# Autodesk Inventor assembly: Z-Axis
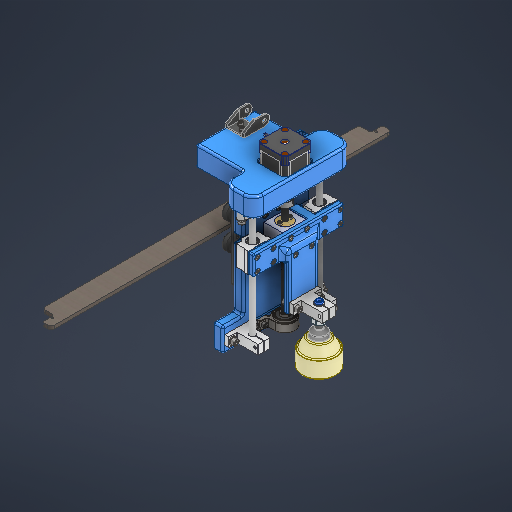
[picture p0: Inventor's stored thumbnail of the model, 512x512]
Saved by Autodesk Inventor 2027.1 (Build 311270010, 270A)
## iProperties
Created: 2026-10-04
Part Number: Z-Axis
Document SubType Name: Assembly
Designer: Ahmed
Author: Ahmed
## iProperties of the stored document nippel.ipt
Created: 2014-03-17
Part Number: nippel
Material: Generic
Document SubType Name: Modeling
Designer: Ahmed
Density: 1 g/cm^3
Appearance: Default
Mass: 1.51643 g
Surface Area: 12.4065 cm^2
Volume: 1.51643 cm^3
Sending System: SOLIDWORKS 2012
Last Saved Date: 2014-05-13
last saved by: Oleg
Author: Ahmed
## iProperties of the stored document Gantry_Plate_65x65.ipt
Created: 2024-03-15
Part Number: Gantry_Plate_65x65
Material: Generic
Description: STEP AP214
Document SubType Name: Modeling
Designer: Ahmed
Density: 1 g/cm^3
Appearance: Default
Mass: 10.5497 g
Surface Area: 93.2193 cm^2
Volume: 10.5497 cm^3
Sending System: SolidWorks 2024
Preprocessor: SwSTEP 2.0
Title: Gantry_Plate_65x65.STEP
Revision Number: ANY
## iProperties of the stored document IPCF06-02.iam
Company: Open CASCADE
Created: 2026-10-23
Part Number: IPCF06-02
Description: Open CASCADE Model
Document SubType Name: Assembly
Designer: Ahmed
Authority: Unknown
Mass: 1.21454 g
Surface Area: 16.1477 cm^2
Volume: 1.21454 cm^3
Density: 1 g/cm^3
Sending System: Open CASCADE 7.9
Preprocessor: Open CASCADE STEP processor 7.9
Title: Open CASCADE Shape Model
Author: Author
## iProperties of the stored document Insert M3 D5 L5mm.ipt
Created: 2022-05-23
Part Number: Document
Material: Generic
Document SubType Name: Modeling
Designer: Ahmed
Density: 1 g/cm^3
Appearance: Default
Mass: 0.0567155 g
Surface Area: 2.1125 cm^2
Volume: 0.0567155 cm^3
Preprocessor: ST-DEVELOPER v16.5
Title: Insert M3 D5 L5mm
Revision Number: AFirst version
## iProperties of the stored document Suction-ohne-nippel.ipt
Created: 2014-03-17
Part Number: Suction-ohne-nippel
Material: Generic
Document SubType Name: Modeling
Designer: Ahmed
Density: 1 g/cm^3
Appearance: Default
Mass: 1.14453 g
Surface Area: 25.0648 cm^2
Volume: 1.14453 cm^3
Sending System: SOLIDWORKS 2012
Last Saved Date: 2014-05-13
last saved by: Oleg
Author: Ahmed
## iProperties of the stored document release_ring.ipt
Created: 2026-10-23
Part Number: release_ring
Material: Generic
Document SubType Name: Modeling
Designer: Ahmed
Density: 1 g/cm^3
Appearance: Default
Mass: 0.104785 g
Surface Area: 2.06972 cm^2
Volume: 0.104785 cm^3
Author: Ahmed
## iProperties of the stored document Suction.iam
Created: 2014-03-17
Part Number: Suction
Document SubType Name: Assembly
Designer: Ahmed
Mass: 2.66095 g
Surface Area: 37.4713 cm^2
Volume: 2.66095 cm^3
Density: 1 g/cm^3
Sending System: SOLIDWORKS 2012
last saved by: Oleg
Last Saved Date: 2014-05-13
Author: Ahmed
## iProperties of the stored document body.ipt
Created: 2026-10-23
Part Number: body
Material: Generic
Document SubType Name: Modeling
Designer: Ahmed
Density: 1 g/cm^3
Appearance: Default
Mass: 1.10976 g
Surface Area: 14.0779 cm^2
Volume: 1.10976 cm^3
Author: Ahmed
## Documents named in this file (57)
- C:\Users\Ahmed\Desktop\Fall 26\MCT333 Design of Mechatronics Systems 1\Project\CAD\Z-Axis.iam
- C:\Users\Ahmed\Desktop\Fall 26\MCT333 Design of Mechatronics Systems 1\Project\CAD\AluminumExtrusion\AluminumExtrusion\AluminiumExtrusion2020\2020extrusion_ipt\2020aluminum_extrusion_black.ipt
- C:\Users\Ahmed\Desktop\Fall 26\MCT333 Design of Mechatronics Systems 1\Project\CAD\V-Pulley.ipt
- C:\Users\Ahmed\Desktop\Fall 26\MCT333 Design of Mechatronics Systems 1\Project\CAD\VSoltGantrySetAllSizes\VSoltGantrySetAllSizes\40mm Gantry Set universal\127x88 Gantry.ipt
- C:\Users\Ahmed\Desktop\Fall 26\MCT333 Design of Mechatronics Systems 1\Project\CAD\sk8-linear-shaft-support-8mm-1.snapshot.1\SK8 Linear Shaft Support, 8mm v4\SK8 Linear Shaft Support, 8mm v4.ipt
- C:\Users\Ahmed\Desktop\Fall 26\MCT333 Design of Mechatronics Systems 1\Project\CAD\scs8uu-linear-bearing-block-8mm-shaft-1.snapshot.1\SCS8UU Block, Linear Bearing, 8mm Shaft v4\SCS8UU Block, Linear Bearing, 8mm.ipt
- C:\Users\Ahmed\Desktop\Fall 26\MCT333 Design of Mechatronics Systems 1\Project\CAD\shf10-shf8-linear-shaft-support-1.snapshot.6\SHF8\SHF8.ipt
- C:\Users\Ahmed\Desktop\Fall 26\MCT333 Design of Mechatronics Systems 1\Project\CAD\KP08 Pillow block bearing 08mm diameter\KP08 Pillow block bearing 08mm diameter.ipt
- C:\Users\Ahmed\Desktop\Fall 26\MCT333 Design of Mechatronics Systems 1\Project\CAD\nema-17-40mm-stepper-motor-1.snapshot.22\17HM15-0904S\17HM15-0904S\17HM15-0904S.ipt
- C:\Users\Ahmed\Desktop\Fall 26\MCT333 Design of Mechatronics Systems 1\Project\CAD\aluminum-flexible-shaft-coupling-5mm-x-8mm-1.snapshot.1\Flexible Shaft Coupling 5mm to 8mm\Flexible_Shaft_Coupling_5_to_8mm v7.ipt
- C:\Users\Ahmed\Desktop\Fall 26\MCT333 Design of Mechatronics Systems 1\Project\CAD\Z Bracket.ipt
- C:\Users\Ahmed\Desktop\Fall 26\MCT333 Design of Mechatronics Systems 1\Project\CAD\tr8x8-4-8mm-4-start-lead-screw-1.snapshot.6\Trapezoidal lead screw tr8x8-4\Trapezoidal lead screw tr8x8-4.ipt
- C:\Users\Ahmed\Desktop\Fall 26\MCT333 Design of Mechatronics Systems 1\Project\CAD\t8_nut_housing\t8_nut_housing.ipt
- C:\Users\Ahmed\Desktop\Fall 26\MCT333 Design of Mechatronics Systems 1\Project\CAD\shf10-shf8-linear-shaft-support-1.snapshot.6\SHF8\SHF8_MIR.ipt
- C:\Users\Ahmed\Desktop\Fall 26\MCT333 Design of Mechatronics Systems 1\Project\CAD\Linear Guide Rods.ipt
- C:\Users\Ahmed\Documents\Inventor\Content Center Files\R2027\en-US\ISO 4032(2)\ISO 4032 - M5 - ISO.ipt
- C:\Users\Ahmed\Documents\Inventor\Content Center Files\R2027\en-US\ISO 4762(2)\ISO 4762 - M5 x 16ISO.ipt
- C:\Users\Ahmed\Desktop\Fall 26\MCT333 Design of Mechatronics Systems 1\Project\CAD\Bearing Spacer.ipt
- C:\Users\Ahmed\Desktop\Fall 26\MCT333 Design of Mechatronics Systems 1\Project\CAD\Insert M5 D7 L9.5mm\Insert M5 D7 L9.5mm.ipt
- C:\Users\Ahmed\Desktop\Fall 26\MCT333 Design of Mechatronics Systems 1\Project\CAD\M4 Insert\M4 Insert.ipt
- C:\Users\Ahmed\Documents\Inventor\Content Center Files\R2027\en-US\ISO 4762(2)\ISO 4762 - M5 x 20ISO.ipt
- C:\Users\Ahmed\Documents\Inventor\Content Center Files\R2027\en-US\ISO 4762(2)\ISO 4762 - M4 x 16ISO.ipt
- C:\Users\Ahmed\Documents\Inventor\Content Center Files\R2027\en-US\ISO 4762(2)\ISO 4762 - M3 x 16ISO.ipt
- C:\Users\Ahmed\Desktop\Fall 26\MCT333 Design of Mechatronics Systems 1\Project\CAD\Linear Bearing Spacer.ipt
- C:\Users\Ahmed\Desktop\Fall 26\MCT333 Design of Mechatronics Systems 1\Project\CAD\T8 nut\T8 nut.ipt
- C:\Users\Ahmed\Documents\Inventor\Content Center Files\R2027\en-US\ISO 4762(2)\ISO 4762 - M3 x 12ISO.ipt
- C:\Users\Ahmed\Desktop\Fall 26\MCT333 Design of Mechatronics Systems 1\Project\CAD\NO-NC Bump Switch\NO-NC Bump Switch.ipt
- C:\Users\Ahmed\Desktop\Fall 26\MCT333 Design of Mechatronics Systems 1\Project\CAD\Limit Switch Spacer.ipt
- C:\Users\Ahmed\Desktop\Fall 26\MCT333 Design of Mechatronics Systems 1\Project\CAD\SK12 SHAFT HOLDER\SK12 SHAFT HOLDER.ipt
- C:\Users\Ahmed\Desktop\Fall 26\MCT333 Design of Mechatronics Systems 1\Project\CAD\Suction Cup Fixation.ipt
- **C:\Users\Ahmed\Desktop\Fall 26\MCT333 Design of Mechatronics Systems 1\Project\CAD\Z-Axis.iam*LocalDocs*xAaaaqrcaAaaaaaaaAaaaavx32f*Suction.iam
- C:\Users\Ahmed\Documents\Inventor\Content Center Files\R2027\en-US\ISO 4762(2)\ISO 4762 - M4 x 12ISO.ipt
- C:\Users\Ahmed\Documents\Inventor\Content Center Files\R2027\en-US\ISO 4762(2)\ISO 4762 - M4 x 8ISO.ipt
- C:\Users\Ahmed\Desktop\Fall 26\MCT333 Design of Mechatronics Systems 1\Project\CAD\Product Base.ipt
- **C:\Users\Ahmed\Desktop\Fall 26\MCT333 Design of Mechatronics Systems 1\Project\CAD\Z-Axis.iam*LocalDocs*xAaaaa4daAaaaaaaaAaaaqi4fEb*IPCF06-02.iam
- C:\Users\Ahmed\Documents\Inventor\Content Center Files\R2027\en-US\ANSI B18.22 M\ANSI B18.22M - 5 N.ipt
- C:\Users\Ahmed\Documents\Inventor\Content Center Files\R2027\en-US\ISO 4032(2)\ISO 4032 - M2 - ISO.ipt
- C:\Users\Ahmed\Documents\Inventor\Content Center Files\R2027\en-US\ANSI B18.22 M\ANSI B18.22M - 2 N.ipt
- C:\Users\Ahmed\Documents\Inventor\Content Center Files\R2027\en-US\ISO 4762(2)\ISO 4762 - M2 x 16ISO.ipt
- **C:\Users\Ahmed\Desktop\Fall 26\MCT333 Design of Mechatronics Systems 1\Project\CAD\Z-Axis.iam*LocalDocs*xAaaaq5baAaaaaaaaAaaaqochXh*Insert M3 D5 L5mm.ipt
- C:\Users\Ahmed\Documents\Inventor\Content Center Files\R2027\en-US\ANSI B18.22 M\ANSI B18.22M - 3 N.ipt
- **C:\Users\Ahmed\Desktop\Fall 26\MCT333 Design of Mechatronics Systems 1\Project\CAD\Z-Axis.iam*LocalDocs*xAaaaq4baAaaaaaaaAaaaa31b2g*Gantry_Plate_65x65.ipt
- C:\Users\Ahmed\Desktop\Fall 26\MCT333 Design of Mechatronics Systems 1\Project\CAD\Drag Chain Support.ipt
- C:\Users\Ahmed\Desktop\Fall 26\MCT333 Design of Mechatronics Systems 1\Project\CAD\Drag Chain Start Link.ipt
- C:\Users\Ahmed\Desktop\Fall 26\MCT333 Design of Mechatronics Systems 1\Project\CAD\Drag Chain Middle Link.ipt
- C:\Users\Ahmed\Desktop\Fall 26\MCT333 Design of Mechatronics Systems 1\Project\CAD\Path.ipt
- C:\Users\Ahmed\Desktop\Fall 26\MCT333 Design of Mechatronics Systems 1\Project\CAD\GT2 Belt 6mm x 40mm\GT2 Belt 6mm x 40mm.ipt
- C:\Users\Ahmed\Desktop\Fall 26\MCT333 Design of Mechatronics Systems 1\Project\CAD\Insert M3 D5 L5mm.stp
- **C:\Users\Ahmed\Desktop\Fall 26\MCT333 Design of Mechatronics Systems 1\Project\CAD\Z-Axis.iam*LocalDocs*xAaaaqcaaAaaaaaaaAaaaartaHg*nippel.ipt
- **C:\Users\Ahmed\Desktop\Fall 26\MCT333 Design of Mechatronics Systems 1\Project\CAD\Z-Axis.iam*LocalDocs*xAaaaqzaaAaaaaaaaAaaaqmsjBh*body.ipt
- **C:\Users\Ahmed\Desktop\Fall 26\MCT333 Design of Mechatronics Systems 1\Project\CAD\Z-Axis.iam*LocalDocs*xAaaaqibaAaaaaaaaAaaaq5znNd*release_ring.ipt
- **C:\Users\Ahmed\Desktop\Fall 26\MCT333 Design of Mechatronics Systems 1\Project\CAD\Z-Axis.iam*LocalDocs*xAaaaqocaAaaaaaaaAaaaahhiSh*Suction-ohne-nippel.ipt
- C:\Users\Ahmed\Desktop\Fall 26\MCT333 Design of Mechatronics Systems 1\Project\CAD\Suction.SLDASM
- C:\Users\Ahmed\Desktop\Fall 26\MCT333 Design of Mechatronics Systems 1\Project\CAD\nippel.SLDPRT
- C:\Users\Ahmed\Desktop\Fall 26\MCT333 Design of Mechatronics Systems 1\Project\CAD\Suction-ohne-nippel.SLDPRT
- C:\Users\Ahmed\Desktop\Fall 26\MCT333 Design of Mechatronics Systems 1\Project\CAD\IPCF06-02.step
- C:\Users\Ahmed\Desktop\Fall 26\MCT333 Design of Mechatronics Systems 1\Project\CAD\Gantry_Plate_65x65.STEP
## Components (168 placed, 46 different names)
1. 2020aluminum_extrusion_black:1 — Tangent:9, Tangent:10, Tangent:11, Tangent:12, Mate:245, Mate:246, Mate:247, Mate:248, Mate:249, Mate:250, Mate:252, Mate:264, Mate:266, Flush:22, Flush:23
2. SCS8UU Block, Linear Bearing, 8mm:1 — Mate:34, Angle:5, Flush:5, Mate:78
3. 17HS4401:1 — Mate:7, Mate:8, Mate:224, Mate:225
4. Flexible_Shaft_Coupling_5_to_8mm v7:1 — Mate:8, Mate:10, Mate:12, Mate:33, Mate:63
5. Z Bracket:1 — Mate:2, Mate:3, Mate:4, Mate:7, Mate:10, Angle:1, Mate:18, Mate:19, Mate:20, Mate:21, Mate:22, Mate:26, Mate:27, Mate:28, Mate:30, Mate:32, Angle:6, Mate:38, Angle:7, Mate:41, Mate:42, Mate:43, Mate:44, Mate:45, Mate:47, Mate:48, Mate:49, Mate:50, Mate:51, Mate:52, Mate:53, Flush:7, Mate:54, Flush:8, Mate:55, Flush:9, Mate:56, Flush:10, Mate:57, Mate:58, Mate:59, Mate:60, Flush:11, Flush:12, Flush:13, Flush:14, Mate:61, Mate:62, Flush:15, Flush:16, Insert:15, Insert:16, Insert:17, Insert:18, Insert:23, Insert:24, Insert:25, Insert:26, Insert:29, Insert:30, Insert:31, Insert:32, Insert:35, Insert:36, Mate:206, Mate:209, Mate:210, Angle:8, Mate:217, Insert:37, Insert:38, Mate:235, Flush:17, Mate:236, Flush:18, Mate:257, Flush:25
6. Trapezoidal lead screw tr8x8-4:1 — Mate:12, Mate:13, Mate:33
7. t8_nut_housing:1 — Mate:13, Angle:1, Angle:4, Angle:5, Flush:5, Flush:6, Mate:63, Mate:81, Mate:82, Mate:83, Mate:107, Mate:109
8. SCS8UU Block, Linear Bearing, 8mm:2 — Mate:35, Angle:4, Flush:6, Mate:75, Mate:76
9. M4 Insert:1 — Mate:61, Flush:16
10. M4 Insert:2 — Mate:62, Flush:15
11. ISO 4762 M3 x 16:1 — Insert:23
12. ISO 4762 M3 x 16:2 — Insert:24, Mate:225
13. ISO 4762 M3 x 16:3 — Insert:25, Mate:224
14. ISO 4762 M3 x 16:4 — Insert:26
15. Linear Bearing Spacer:1 — Mate:78, Mate:148, Mate:149
16. Linear Bearing Spacer:2 — Mate:75, Mate:76, Mate:108, Mate:179
17. T8 nut:1 — Mate:81, Mate:82, Mate:83, Mate:84, Mate:85, Mate:86, Mate:87
18. ISO 4762 M3 x 12:1 — Mate:84, Mate:87
19. ISO 4762 M3 x 12:2 — Mate:85, Mate:86
20. SK12 SHAFT HOLDER:1 — Mate:110, Mate:111, Mate:112, Mate:113, Mate:114, Mate:134, Mate:135, Mate:136, Mate:137, Mate:146, Insert:47
21. Suction Cup Fixation:1 — Mate:107, Mate:108, Mate:109, Mate:110, Mate:111, Mate:112, Mate:118, Mate:119, Mate:120, Mate:121, Mate:122, Mate:123, Mate:124, Mate:125, Mate:126, Mate:127, Mate:128, Mate:129, Mate:130, Mate:131, Mate:132, Mate:133, Mate:150, Mate:151, Mate:152, Mate:153, Mate:154, Mate:155, Mate:156, Mate:157, Insert:33, Insert:34
22. Suction:1 [sub-assembly] — Mate:113, Mate:114, Mate:144, Mate:145, Mate:147
23. ISO 4762 M4 x 12:2 — Mate:118, Mate:120
24. ISO 4762 M4 x 12:1 — Mate:119, Mate:121
25. ISO 4762 M4 x 12:3 — Mate:123, Mate:124, Mate:149
26. ISO 4762 M4 x 12:4 — Mate:122, Mate:125, Mate:148
27. ISO 4762 M4 x 12:5 — Mate:151, Mate:155, Mate:179
28. ISO 4762 M4 x 8:1 — Mate:126, Mate:127
29. ISO 4762 M4 x 8:2 — Mate:128, Mate:129
30. ISO 4762 M4 x 16:3 — Mate:130, Mate:133
31. ISO 4762 M4 x 16:4 — Mate:131, Mate:132
32. ISO 4762 M5 x 20:14 — Mate:134, Mate:135, Mate:158
33. ISO 4762 M5 x 20:13 — Mate:136, Mate:137, Mate:160
34. Product Base:1 — Mate:144, Mate:145
35. IPCF06-02:1 [sub-assembly] — Mate:146, Mate:147
36. ISO 4762 M4 x 12:6 — Mate:150, Mate:154
37. ISO 4762 M4 x 12:7 — Mate:152, Mate:157
38. ISO 4762 M4 x 12:8 — Mate:153, Mate:156
39. ISO 4032 M5:13 — Mate:158, Mate:161
40. ISO 4032 M5:14 — Mate:160, Mate:162
41. Plain Washer (Metric) 5 N:1 — Insert:33, Mate:161
42. Plain Washer (Metric) 5 N:2 — Insert:34, Mate:162
43. Limit Switch Spacer:1 — Mate:206, Mate:207, Mate:208, Mate:211
44. Insert M3 D5 L5mm:1 — Mate:235, Flush:17, Mate:238
45. Insert M3 D5 L5mm:2 — Mate:236, Flush:18, Mate:237, Mate:268
46. ISO 4762 M3 x 12:3 — Mate:238, Mate:242, Mate:244
47. ISO 4762 M3 x 12:4 — Mate:237, Mate:239, Mate:240
48. Plain Washer (Metric) 3 N:2 — Mate:242, Mate:244, Mate:270
49. Plain Washer (Metric) 3 N:1 — Mate:239, Mate:240, Mate:269
50. Gantry_Plate_65x65:1 — Mate:248, Mate:249, Mate:250, Mate:251, Mate:253
51. Gantry_Plate_65x65:2 — Mate:245, Mate:246, Mate:247, Mate:263, Mate:272
52. Drag Chain Support:1 — Mate:251, Mate:252, Mate:253, Mate:254, Angle:9, Mate:267, Angle:10
53. Drag Chain Start Link:1 — Mate:257, Mate:264, Mate:268, Mate:269, Mate:270, Mate:272, Flush:19
54. Drag Chain Start Link:2 — Mate:254, Angle:9, Mate:266, Mate:267, Mate:273, Flush:20
55. Path:1 — Flush:19
56. GT2 Belt 6mm x 40mm:1 — Flush:21, Flush:22
57. GT2 Belt 6mm x 40mm:2 — Flush:23, Flush:24
58. ISO 4762 M4 x 16:5 — Insert:47
59. Plain Washer (Metric) 2 N:5 — Mate:233
60. Plain Washer (Metric) 2 N:4 — Mate:234
61. Limit Switch Spacer:2 — Mate:213, Mate:214, Mate:216, Angle:8, Mate:217
62. NO-NC Bump Switch:2 — Mate:213, Mate:214, Mate:216, Mate:219, Mate:231, Mate:232, Mate:233, Mate:234, Flush:25
63. ISO 4032 M2:3 — Insert:37
64. ISO 4032 M2:4 — Insert:38
65. ISO 4762 M2 x 16:3 — Mate:231
66. ISO 4762 M2 x 16:4 — Mate:232
67. NO-NC Bump Switch:3 — Mate:197, Mate:198, Mate:201, Mate:203, Mate:211
68. ISO 4032 M2:2 — Insert:36
69. ISO 4032 M2:1 — Insert:35
70. ISO 4762 M2 x 16:2 — Mate:197, Mate:200, Mate:205, Mate:208, Mate:210
71. ISO 4762 M2 x 16:1 — Mate:198, Mate:202, Mate:204, Mate:207, Mate:209
72. Plain Washer (Metric) 2 N:2 — Mate:200, Mate:201, Mate:205
73. Plain Washer (Metric) 2 N:3 — Mate:202, Mate:203, Mate:204
74. 127x88 Gantry:1 — Insert:2, Insert:4, Mate:2, Mate:3, Mate:4, Insert:27, Insert:28, Mate:164, Mate:168, Mate:169, Mate:170, Mate:175, Mate:176, Mate:177, Mate:178, Mate:263, Flush:21, Flush:24
75. V-Pulley:1 — Insert:2
76. V-Pulley:2 — Insert:4
77. V-Pulley:3 — Insert:28, Tangent:11, Tangent:12
78. V-Pulley:4 — Insert:27, Tangent:9, Tangent:10
79. ISO 4762 M5 x 20:11 — Insert:30, Mate:103, Mate:163
80. ISO 4032 M5:10 — Mate:100, Mate:103
81. Plain Washer (Metric) 5 N:3 — Mate:163, Mate:164, Mate:100
82. ISO 4762 M5 x 20:5 — Insert:15, Mate:88, Mate:167
83. ISO 4032 M5:6 — Mate:88, Mate:89
84. Plain Washer (Metric) 5 N:5 — Mate:167, Mate:168, Mate:89
85. ISO 4762 M5 x 20:6 — Insert:16, Mate:90, Mate:166
86. ISO 4032 M5:7 — Mate:90, Mate:95
87. Plain Washer (Metric) 5 N:4 — Mate:166, Mate:169, Mate:95
88. ISO 4762 M5 x 20:10 — Insert:31, Mate:102, Mate:165
89. ISO 4032 M5:12 — Mate:98, Mate:102
90. Plain Washer (Metric) 5 N:6 — Mate:165, Mate:170, Mate:98
91. ISO 4762 M5 x 20:7 — Insert:17, Mate:92, Mate:172
92. ISO 4032 M5:9 — Mate:92, Mate:93
93. Plain Washer (Metric) 5 N:8 — Mate:172, Mate:177, Mate:93
94. ISO 4762 M5 x 20:8 — Insert:18, Mate:91, Mate:173
95. ISO 4032 M5:8 — Mate:91, Mate:94
96. Plain Washer (Metric) 5 N:10 — Mate:173, Mate:176, Mate:94
97. ISO 4762 M5 x 20:12 — Insert:32, Mate:101, Mate:171
98. ISO 4032 M5:11 — Mate:99, Mate:101
99. Plain Washer (Metric) 5 N:9 — Mate:171, Mate:178, Mate:99
100. ISO 4762 M5 x 20:9 — Insert:29, Mate:96, Mate:174
101. ISO 4032 M5:5 — Mate:96, Mate:97
102. Plain Washer (Metric) 5 N:7 — Mate:174, Mate:175, Mate:97
103. KP08 Pillow block bearing 08mm diameter:1 — Mate:47, Mate:48, Mate:49, Insert:13, Insert:14
104. ISO 4762 M4 x 16:1 — Insert:13
105. Bearing Spacer:1 — Mate:50, Mate:51, Mate:52, Mate:219
106. ISO 4762 M4 x 16:2 — Insert:14
107. Linear Guide Rods:2 — Mate:29, Mate:30, Mate:35
108. Linear Guide Rods:1 — Mate:32, Mate:34, Mate:36, Mate:46
109. SHF8:1 — Mate:19, Mate:20, Mate:21, Mate:22, Insert:5, Insert:6, Insert:43, Insert:44
110. SHF8_MIR:1 — Mate:26, Mate:27, Mate:28, Insert:7, Insert:8, Insert:45, Insert:46
111. SK8 Linear Shaft Support, 8mm v4:1 — Mate:18, Mate:29, Mate:41, Mate:42, Insert:9, Insert:10, Insert:39, Insert:40
112. SK8 Linear Shaft Support, 8mm v4:2 — Mate:43, Mate:44, Mate:45, Mate:46, Insert:11, Insert:12, Insert:41, Insert:42
113. Insert M5 D7 L9.5mm:1 — Mate:53, Flush:7
114. Insert M5 D7 L9.5mm:2 — Mate:54, Flush:8
115. Insert M5 D7 L9.5mm:3 — Mate:55, Flush:9
116. Insert M5 D7 L9.5mm:4 — Mate:56, Flush:10
117. Insert M5 D7 L9.5mm:5 — Mate:58, Flush:13
118. Insert M5 D7 L9.5mm:6 — Mate:57, Flush:14
119. Insert M5 D7 L9.5mm:7 — Mate:59, Flush:11
120. Insert M5 D7 L9.5mm:8 — Mate:60, Flush:12
121. ISO 4762 M5 x 20:1 — Insert:5
122. Plain Washer (Metric) 5 N:15 — Insert:43
123. ISO 4762 M5 x 20:2 — Insert:6
124. Plain Washer (Metric) 5 N:16 — Insert:44
125. ISO 4762 M5 x 20:3 — Insert:7
126. Plain Washer (Metric) 5 N:18 — Insert:45
127. ISO 4762 M5 x 20:4 — Insert:8
128. Plain Washer (Metric) 5 N:17 — Insert:46
129. ISO 4762 M5 x 16:4 — Insert:11
130. Plain Washer (Metric) 5 N:13 — Insert:41
131. ISO 4762 M5 x 16:3 — Insert:12
132. Plain Washer (Metric) 5 N:14 — Insert:42
133. Plain Washer (Metric) 5 N:12 — Insert:40
134. ISO 4762 M5 x 16:2 — Insert:10
135. Plain Washer (Metric) 5 N:11 — Insert:39
136. ISO 4762 M5 x 16:1 — Insert:9
137. Drag Chain Middle Link:1 — Mate:273, Angle:10, Flush:20
138. Drag Chain Middle Link:2
139. Drag Chain Middle Link:3
140. Drag Chain Middle Link:4
141. Drag Chain Middle Link:5
142. Drag Chain Middle Link:6
143. Drag Chain Middle Link:7
144. Drag Chain Middle Link:8
145. Drag Chain Middle Link:9
146. Drag Chain Middle Link:10
147. Drag Chain Middle Link:11
148. Drag Chain Middle Link:12
149. Drag Chain Middle Link:13
150. Drag Chain Middle Link:14
151. Drag Chain Middle Link:15
152. Drag Chain Middle Link:16
153. Drag Chain Middle Link:17
154. Drag Chain Middle Link:18
155. Drag Chain Middle Link:19
156. Drag Chain Middle Link:20
157. Drag Chain Middle Link:21
158. Drag Chain Middle Link:22
159. Drag Chain Middle Link:23
160. Drag Chain Middle Link:24
161. Drag Chain Middle Link:25
162. Drag Chain Middle Link:26
163. Drag Chain Middle Link:27
164. Drag Chain Middle Link:28
165. Drag Chain Middle Link:29
166. Drag Chain Middle Link:30
167. Drag Chain Middle Link:31
168. Drag Chain Middle Link:32
## Component patterns: (32 elements, first: Drag Chain Middle Link:1)
## Relationships (269: Mate 195, Insert 41, Flush 21, Angle 8, Tangent 4)
- Insert:2: 127x88 Gantry:1 ↔ V-Pulley:1
- Insert:4: 127x88 Gantry:1 ↔ V-Pulley:2
- Mate:2: Z Bracket:1 ↔ 127x88 Gantry:1
- Mate:3: Z Bracket:1 ↔ 127x88 Gantry:1
- Mate:4: Z Bracket:1 ↔ 127x88 Gantry:1
- Mate:7: 17HS4401:1 ↔ Z Bracket:1
- Mate:8: 17HS4401:1 ↔ Flexible_Shaft_Coupling_5_to_8mm v7:1
- Mate:10: Flexible_Shaft_Coupling_5_to_8mm v7:1 ↔ Z Bracket:1
- Mate:12: Flexible_Shaft_Coupling_5_to_8mm v7:1 ↔ Trapezoidal lead screw tr8x8-4:1
- Mate:13: Trapezoidal lead screw tr8x8-4:1 ↔ t8_nut_housing:1
- Angle:1 (0 deg): Z Bracket:1 ↔ t8_nut_housing:1
- Mate:18: Z Bracket:1 ↔ SK8 Linear Shaft Support, 8mm v4:1
- Mate:19: Z Bracket:1 ↔ SHF8:1
- Mate:20: Z Bracket:1 ↔ SHF8:1
- Mate:21: Z Bracket:1 ↔ SHF8:1
- Mate:22: Z Bracket:1 ↔ SHF8:1
- Mate:26: Z Bracket:1 ↔ SHF8_MIR:1
- Mate:27: Z Bracket:1 ↔ SHF8_MIR:1
- Mate:28: Z Bracket:1 ↔ SHF8_MIR:1
- Mate:29: Linear Guide Rods:2 ↔ SK8 Linear Shaft Support, 8mm v4:1
- Mate:30: Z Bracket:1 ↔ Linear Guide Rods:2
- Mate:32: Z Bracket:1 ↔ Linear Guide Rods:1
- Mate:33: Flexible_Shaft_Coupling_5_to_8mm v7:1 ↔ Trapezoidal lead screw tr8x8-4:1
- Mate:34: SCS8UU Block, Linear Bearing, 8mm:1 ↔ Linear Guide Rods:1
- Mate:35: SCS8UU Block, Linear Bearing, 8mm:2 ↔ Linear Guide Rods:2
- Angle:4 (0 deg): t8_nut_housing:1 ↔ SCS8UU Block, Linear Bearing, 8mm:2
- Angle:5 (0 deg): SCS8UU Block, Linear Bearing, 8mm:1 ↔ t8_nut_housing:1
- Mate:36: Linear Guide Rods:1
- Mate:37
- Angle:6 (90 deg): Z Bracket:1
- Mate:38: Z Bracket:1
- Mate:39
- Angle:7 (90 deg): Z Bracket:1
- Flush:5: SCS8UU Block, Linear Bearing, 8mm:1 ↔ t8_nut_housing:1
- Flush:6: t8_nut_housing:1 ↔ SCS8UU Block, Linear Bearing, 8mm:2
- Mate:41: Z Bracket:1 ↔ SK8 Linear Shaft Support, 8mm v4:1
- Mate:42: Z Bracket:1 ↔ SK8 Linear Shaft Support, 8mm v4:1
- Mate:43: Z Bracket:1 ↔ SK8 Linear Shaft Support, 8mm v4:2
- Mate:44: Z Bracket:1 ↔ SK8 Linear Shaft Support, 8mm v4:2
- Mate:45: Z Bracket:1 ↔ SK8 Linear Shaft Support, 8mm v4:2
- Mate:46: Linear Guide Rods:1 ↔ SK8 Linear Shaft Support, 8mm v4:2
- Mate:47: Z Bracket:1 ↔ KP08 Pillow block bearing 08mm diameter:1
- Mate:48: Z Bracket:1 ↔ KP08 Pillow block bearing 08mm diameter:1
- Mate:49: Z Bracket:1 ↔ KP08 Pillow block bearing 08mm diameter:1
- Mate:50: Z Bracket:1 ↔ Bearing Spacer:1
- Mate:51: Z Bracket:1 ↔ Bearing Spacer:1
- Mate:52: Z Bracket:1 ↔ Bearing Spacer:1
- Mate:53: Z Bracket:1 ↔ Insert M5 D7 L9.5mm:1
- Flush:7: Z Bracket:1 ↔ Insert M5 D7 L9.5mm:1
- Mate:54: Z Bracket:1 ↔ Insert M5 D7 L9.5mm:2
- Flush:8: Z Bracket:1 ↔ Insert M5 D7 L9.5mm:2
- Mate:55: Z Bracket:1 ↔ Insert M5 D7 L9.5mm:3
- Flush:9: Z Bracket:1 ↔ Insert M5 D7 L9.5mm:3
- Mate:56: Z Bracket:1 ↔ Insert M5 D7 L9.5mm:4
- Flush:10: Z Bracket:1 ↔ Insert M5 D7 L9.5mm:4
- Mate:57: Z Bracket:1 ↔ Insert M5 D7 L9.5mm:6
- Mate:58: Z Bracket:1 ↔ Insert M5 D7 L9.5mm:5
- Mate:59: Z Bracket:1 ↔ Insert M5 D7 L9.5mm:7
- Mate:60: Z Bracket:1 ↔ Insert M5 D7 L9.5mm:8
- Flush:11: Z Bracket:1 ↔ Insert M5 D7 L9.5mm:7
- Flush:12: Z Bracket:1 ↔ Insert M5 D7 L9.5mm:8
- Flush:13: Z Bracket:1 ↔ Insert M5 D7 L9.5mm:5
- Flush:14: Z Bracket:1 ↔ Insert M5 D7 L9.5mm:6
- Mate:61: Z Bracket:1 ↔ M4 Insert:1
- Mate:62: Z Bracket:1 ↔ M4 Insert:2
- Flush:15: Z Bracket:1 ↔ M4 Insert:2
- Flush:16: Z Bracket:1 ↔ M4 Insert:1
- Insert:5 (1.4 mm): SHF8:1 ↔ ISO 4762 M5 x 20:1
- Insert:6 (1.4 mm): SHF8:1 ↔ ISO 4762 M5 x 20:2
- Insert:7 (1.4 mm): SHF8_MIR:1 ↔ ISO 4762 M5 x 20:3
- Insert:8 (1.4 mm): SHF8_MIR:1 ↔ ISO 4762 M5 x 20:4
- Insert:9 (1.4 mm): SK8 Linear Shaft Support, 8mm v4:1 ↔ ISO 4762 M5 x 16:1
- Insert:10 (1.4 mm): SK8 Linear Shaft Support, 8mm v4:1 ↔ ISO 4762 M5 x 16:2
- Insert:11 (1.4 mm): SK8 Linear Shaft Support, 8mm v4:2 ↔ ISO 4762 M5 x 16:4
- Insert:12 (1.4 mm): SK8 Linear Shaft Support, 8mm v4:2 ↔ ISO 4762 M5 x 16:3
- Insert:13: KP08 Pillow block bearing 08mm diameter:1 ↔ ISO 4762 M4 x 16:1
- Insert:14: KP08 Pillow block bearing 08mm diameter:1 ↔ ISO 4762 M4 x 16:2
- Insert:15: Z Bracket:1 ↔ ISO 4762 M5 x 20:5
- Insert:16: Z Bracket:1 ↔ ISO 4762 M5 x 20:6
- Insert:17: Z Bracket:1 ↔ ISO 4762 M5 x 20:7
- Insert:18: Z Bracket:1 ↔ ISO 4762 M5 x 20:8
- Insert:23: Z Bracket:1 ↔ ISO 4762 M3 x 16:1
- Insert:24: Z Bracket:1 ↔ ISO 4762 M3 x 16:2
- Insert:25: Z Bracket:1 ↔ ISO 4762 M3 x 16:3
- Insert:26: Z Bracket:1 ↔ ISO 4762 M3 x 16:4
- Mate:63: Flexible_Shaft_Coupling_5_to_8mm v7:1 ↔ t8_nut_housing:1
- Mate:75: SCS8UU Block, Linear Bearing, 8mm:2 ↔ Linear Bearing Spacer:2
- Mate:76: SCS8UU Block, Linear Bearing, 8mm:2 ↔ Linear Bearing Spacer:2
- Mate:78: SCS8UU Block, Linear Bearing, 8mm:1 ↔ Linear Bearing Spacer:1
- Insert:27: 127x88 Gantry:1 ↔ V-Pulley:4
- Insert:28: 127x88 Gantry:1 ↔ V-Pulley:3
- Tangent:9: 2020aluminum_extrusion_black:1 ↔ V-Pulley:4
- Tangent:10: 2020aluminum_extrusion_black:1 ↔ V-Pulley:4
- Tangent:11: 2020aluminum_extrusion_black:1 ↔ V-Pulley:3
- Tangent:12: 2020aluminum_extrusion_black:1 ↔ V-Pulley:3
- Mate:81: t8_nut_housing:1 ↔ T8 nut:1
- Mate:82: t8_nut_housing:1 ↔ T8 nut:1
- Mate:83: t8_nut_housing:1 ↔ T8 nut:1
- Mate:84: T8 nut:1 ↔ ISO 4762 M3 x 12:1
- Mate:85: T8 nut:1 ↔ ISO 4762 M3 x 12:2
- Mate:86: T8 nut:1 ↔ ISO 4762 M3 x 12:2
- Mate:87: T8 nut:1 ↔ ISO 4762 M3 x 12:1
- Mate:88: ISO 4762 M5 x 20:5 ↔ ISO 4032 M5:6
- Mate:89: ISO 4032 M5:6 ↔ Plain Washer (Metric) 5 N:5
- Mate:90: ISO 4762 M5 x 20:6 ↔ ISO 4032 M5:7
- Mate:91: ISO 4762 M5 x 20:8 ↔ ISO 4032 M5:8
- Mate:92: ISO 4762 M5 x 20:7 ↔ ISO 4032 M5:9
- Mate:93: ISO 4032 M5:9 ↔ Plain Washer (Metric) 5 N:8
- Mate:94: ISO 4032 M5:8 ↔ Plain Washer (Metric) 5 N:10
- Mate:95: ISO 4032 M5:7 ↔ Plain Washer (Metric) 5 N:4
- Insert:29: Z Bracket:1 ↔ ISO 4762 M5 x 20:9
- Insert:30: Z Bracket:1 ↔ ISO 4762 M5 x 20:11
- Insert:31: Z Bracket:1 ↔ ISO 4762 M5 x 20:10
- Insert:32: Z Bracket:1 ↔ ISO 4762 M5 x 20:12
- Mate:96: ISO 4762 M5 x 20:9 ↔ ISO 4032 M5:5
- Mate:97: ISO 4032 M5:5 ↔ Plain Washer (Metric) 5 N:7
- Mate:98: ISO 4032 M5:12 ↔ Plain Washer (Metric) 5 N:6
- Mate:99: ISO 4032 M5:11 ↔ Plain Washer (Metric) 5 N:9
- Mate:100: ISO 4032 M5:10 ↔ Plain Washer (Metric) 5 N:3
- Mate:101: ISO 4762 M5 x 20:12 ↔ ISO 4032 M5:11
- Mate:102: ISO 4762 M5 x 20:10 ↔ ISO 4032 M5:12
- Mate:103: ISO 4762 M5 x 20:11 ↔ ISO 4032 M5:10
- Mate:107: t8_nut_housing:1 ↔ Suction Cup Fixation:1
- Mate:108: Linear Bearing Spacer:2 ↔ Suction Cup Fixation:1
- Mate:109: t8_nut_housing:1 ↔ Suction Cup Fixation:1
- Mate:110: SK12 SHAFT HOLDER:1 ↔ Suction Cup Fixation:1
- Mate:111: SK12 SHAFT HOLDER:1 ↔ Suction Cup Fixation:1
- Mate:112: SK12 SHAFT HOLDER:1 ↔ Suction Cup Fixation:1
- Mate:113: SK12 SHAFT HOLDER:1 ↔ Suction:1
- Mate:114 (4 mm): SK12 SHAFT HOLDER:1 ↔ Suction:1
- Mate:118: Suction Cup Fixation:1 ↔ ISO 4762 M4 x 12:2
- Mate:119: Suction Cup Fixation:1 ↔ ISO 4762 M4 x 12:1
- Mate:120: Suction Cup Fixation:1 ↔ ISO 4762 M4 x 12:2
- Mate:121: Suction Cup Fixation:1 ↔ ISO 4762 M4 x 12:1
- Mate:122: Suction Cup Fixation:1 ↔ ISO 4762 M4 x 12:4
- Mate:123: Suction Cup Fixation:1 ↔ ISO 4762 M4 x 12:3
- Mate:124: Suction Cup Fixation:1 ↔ ISO 4762 M4 x 12:3
- Mate:125: Suction Cup Fixation:1 ↔ ISO 4762 M4 x 12:4
- Mate:126: Suction Cup Fixation:1 ↔ ISO 4762 M4 x 8:1
- Mate:127: Suction Cup Fixation:1 ↔ ISO 4762 M4 x 8:1
- Mate:128: Suction Cup Fixation:1 ↔ ISO 4762 M4 x 8:2
- Mate:129: Suction Cup Fixation:1 ↔ ISO 4762 M4 x 8:2
- Mate:130: Suction Cup Fixation:1 ↔ ISO 4762 M4 x 16:3
- Mate:131: Suction Cup Fixation:1 ↔ ISO 4762 M4 x 16:4
- Mate:132: Suction Cup Fixation:1 ↔ ISO 4762 M4 x 16:4
- Mate:133: Suction Cup Fixation:1 ↔ ISO 4762 M4 x 16:3
- Mate:134: SK12 SHAFT HOLDER:1 ↔ ISO 4762 M5 x 20:14
- Mate:135: SK12 SHAFT HOLDER:1 ↔ ISO 4762 M5 x 20:14
- Mate:136: SK12 SHAFT HOLDER:1 ↔ ISO 4762 M5 x 20:13
- Mate:137: SK12 SHAFT HOLDER:1 ↔ ISO 4762 M5 x 20:13
- Mate:144: Suction:1 ↔ Product Base:1
- Mate:145: Suction:1 ↔ Product Base:1
- Mate:146: SK12 SHAFT HOLDER:1 ↔ IPCF06-02:1
- Mate:147: Suction:1 ↔ IPCF06-02:1
- Mate:148: Linear Bearing Spacer:1 ↔ ISO 4762 M4 x 12:4
- Mate:149: Linear Bearing Spacer:1 ↔ ISO 4762 M4 x 12:3
- Mate:150: Suction Cup Fixation:1 ↔ ISO 4762 M4 x 12:6
- Mate:151: Suction Cup Fixation:1 ↔ ISO 4762 M4 x 12:5
- Mate:152: Suction Cup Fixation:1 ↔ ISO 4762 M4 x 12:7
- Mate:153: Suction Cup Fixation:1 ↔ ISO 4762 M4 x 12:8
- Mate:154: Suction Cup Fixation:1 ↔ ISO 4762 M4 x 12:6
- Mate:155: Suction Cup Fixation:1 ↔ ISO 4762 M4 x 12:5
- Mate:156: Suction Cup Fixation:1 ↔ ISO 4762 M4 x 12:8
- Mate:157: Suction Cup Fixation:1 ↔ ISO 4762 M4 x 12:7
- Mate:158: ISO 4762 M5 x 20:14 ↔ ISO 4032 M5:13
- Mate:160: ISO 4762 M5 x 20:13 ↔ ISO 4032 M5:14
- Insert:33: Suction Cup Fixation:1 ↔ Plain Washer (Metric) 5 N:1
- Insert:34: Suction Cup Fixation:1 ↔ Plain Washer (Metric) 5 N:2
- Mate:161: ISO 4032 M5:13 ↔ Plain Washer (Metric) 5 N:1
- Mate:162: ISO 4032 M5:14 ↔ Plain Washer (Metric) 5 N:2
- Mate:163: ISO 4762 M5 x 20:11 ↔ Plain Washer (Metric) 5 N:3
- Mate:164: 127x88 Gantry:1 ↔ Plain Washer (Metric) 5 N:3
- Mate:165: ISO 4762 M5 x 20:10 ↔ Plain Washer (Metric) 5 N:6
- Mate:166: ISO 4762 M5 x 20:6 ↔ Plain Washer (Metric) 5 N:4
- Mate:167: ISO 4762 M5 x 20:5 ↔ Plain Washer (Metric) 5 N:5
- Mate:168: 127x88 Gantry:1 ↔ Plain Washer (Metric) 5 N:5
- Mate:169: 127x88 Gantry:1 ↔ Plain Washer (Metric) 5 N:4
- Mate:170: 127x88 Gantry:1 ↔ Plain Washer (Metric) 5 N:6
- Mate:171: ISO 4762 M5 x 20:12 ↔ Plain Washer (Metric) 5 N:9
- Mate:172: ISO 4762 M5 x 20:7 ↔ Plain Washer (Metric) 5 N:8
- Mate:173: ISO 4762 M5 x 20:8 ↔ Plain Washer (Metric) 5 N:10
- Mate:174: ISO 4762 M5 x 20:9 ↔ Plain Washer (Metric) 5 N:7
- Mate:175: 127x88 Gantry:1 ↔ Plain Washer (Metric) 5 N:7
- Mate:176: 127x88 Gantry:1 ↔ Plain Washer (Metric) 5 N:10
- Mate:177: 127x88 Gantry:1 ↔ Plain Washer (Metric) 5 N:8
- Mate:178: 127x88 Gantry:1 ↔ Plain Washer (Metric) 5 N:9
- Mate:179: Linear Bearing Spacer:2 ↔ ISO 4762 M4 x 12:5
- Insert:35: Z Bracket:1 ↔ ISO 4032 M2:1
- Insert:36: Z Bracket:1 ↔ ISO 4032 M2:2
- Mate:197: NO-NC Bump Switch:3 ↔ ISO 4762 M2 x 16:2
- Mate:198: NO-NC Bump Switch:3 ↔ ISO 4762 M2 x 16:1
- Mate:200: ISO 4762 M2 x 16:2 ↔ Plain Washer (Metric) 2 N:2
- Mate:201: NO-NC Bump Switch:3 ↔ Plain Washer (Metric) 2 N:2
- Mate:202: ISO 4762 M2 x 16:1 ↔ Plain Washer (Metric) 2 N:3
- Mate:203: NO-NC Bump Switch:3 ↔ Plain Washer (Metric) 2 N:3
- Mate:204: ISO 4762 M2 x 16:1 ↔ Plain Washer (Metric) 2 N:3
- Mate:205: ISO 4762 M2 x 16:2 ↔ Plain Washer (Metric) 2 N:2
- Mate:206: Z Bracket:1 ↔ Limit Switch Spacer:1
- Mate:207: Limit Switch Spacer:1 ↔ ISO 4762 M2 x 16:1
- Mate:208: Limit Switch Spacer:1 ↔ ISO 4762 M2 x 16:2
- Mate:209: Z Bracket:1 ↔ ISO 4762 M2 x 16:1
- Mate:210: Z Bracket:1 ↔ ISO 4762 M2 x 16:2
- Mate:211: Limit Switch Spacer:1 ↔ NO-NC Bump Switch:3
- Mate:213: Limit Switch Spacer:2 ↔ NO-NC Bump Switch:2
- Mate:214: Limit Switch Spacer:2 ↔ NO-NC Bump Switch:2
- Mate:216: Limit Switch Spacer:2 ↔ NO-NC Bump Switch:2
- Angle:8 (180 deg): Z Bracket:1 ↔ Limit Switch Spacer:2
- Mate:217: Z Bracket:1 ↔ Limit Switch Spacer:2
- Mate:219 (33 mm): NO-NC Bump Switch:2 ↔ Bearing Spacer:1
- Mate:224: 17HS4401:1 ↔ ISO 4762 M3 x 16:3
- Mate:225: 17HS4401:1 ↔ ISO 4762 M3 x 16:2
- Insert:37: Z Bracket:1 ↔ ISO 4032 M2:3
- Insert:38: Z Bracket:1 ↔ ISO 4032 M2:4
- [Mate]: Plain Washer (Metric) 2 N:4 ↔ ISO 4762 M2 x 16:3
- [Mate]: Plain Washer (Metric) 2 N:5 ↔ ISO 4762 M2 x 16:4
- [Mate]: Plain Washer (Metric) 2 N:5 ↔ ISO 4762 M2 x 16:4
- [Mate]: Plain Washer (Metric) 2 N:4 ↔ ISO 4762 M2 x 16:3
- Mate:231: NO-NC Bump Switch:2 ↔ ISO 4762 M2 x 16:3
- Mate:232: NO-NC Bump Switch:2 ↔ ISO 4762 M2 x 16:4
- Mate:233: Plain Washer (Metric) 2 N:5 ↔ NO-NC Bump Switch:2
- Mate:234: Plain Washer (Metric) 2 N:4 ↔ NO-NC Bump Switch:2
- Mate:235: Z Bracket:1 ↔ Insert M3 D5 L5mm:1
- Flush:17: Z Bracket:1 ↔ Insert M3 D5 L5mm:1
- Mate:236: Z Bracket:1 ↔ Insert M3 D5 L5mm:2
- Flush:18: Z Bracket:1 ↔ Insert M3 D5 L5mm:2
- Mate:237: Insert M3 D5 L5mm:2 ↔ ISO 4762 M3 x 12:4
- Mate:238: Insert M3 D5 L5mm:1 ↔ ISO 4762 M3 x 12:3
- Mate:239: ISO 4762 M3 x 12:4 ↔ Plain Washer (Metric) 3 N:1
- Mate:240: ISO 4762 M3 x 12:4 ↔ Plain Washer (Metric) 3 N:1
- Mate:242: ISO 4762 M3 x 12:3 ↔ Plain Washer (Metric) 3 N:2
- Mate:244: ISO 4762 M3 x 12:3 ↔ Plain Washer (Metric) 3 N:2
- Mate:245 (-42.5 mm): 2020aluminum_extrusion_black:1 ↔ Gantry_Plate_65x65:2
- Mate:246: 2020aluminum_extrusion_black:1 ↔ Gantry_Plate_65x65:2
- Mate:247: 2020aluminum_extrusion_black:1 ↔ Gantry_Plate_65x65:2
- Mate:248 (-42.5 mm): 2020aluminum_extrusion_black:1 ↔ Gantry_Plate_65x65:1
- Mate:249: 2020aluminum_extrusion_black:1 ↔ Gantry_Plate_65x65:1
- Mate:250: 2020aluminum_extrusion_black:1 ↔ Gantry_Plate_65x65:1
- Mate:251: Gantry_Plate_65x65:1 ↔ Drag Chain Support:1
- Mate:252: 2020aluminum_extrusion_black:1 ↔ Drag Chain Support:1
- Mate:253 (-2.5 mm): Gantry_Plate_65x65:1 ↔ Drag Chain Support:1
- Mate:254: Drag Chain Support:1 ↔ Drag Chain Start Link:2
- Angle:9 (0 deg): Drag Chain Support:1 ↔ Drag Chain Start Link:2
- Mate:257: Z Bracket:1 ↔ Drag Chain Start Link:1
- Mate:263 (-10 mm): Gantry_Plate_65x65:2 ↔ 127x88 Gantry:1
- Mate:264 (1.5 mm): 2020aluminum_extrusion_black:1 ↔ Drag Chain Start Link:1
- Mate:266 (1.5 mm): 2020aluminum_extrusion_black:1 ↔ Drag Chain Start Link:2
- Mate:267 (2 mm): Drag Chain Support:1 ↔ Drag Chain Start Link:2
- Mate:268 (2 mm): Insert M3 D5 L5mm:2 ↔ Drag Chain Start Link:1
- Mate:269: Plain Washer (Metric) 3 N:1 ↔ Drag Chain Start Link:1
- Mate:270: Plain Washer (Metric) 3 N:2 ↔ Drag Chain Start Link:1
- Mate:272 (371.945 mm): Gantry_Plate_65x65:2 ↔ Drag Chain Start Link:1
- Flush:19: Drag Chain Start Link:1 ↔ Path:1
- Mate:273: Drag Chain Start Link:2 ↔ Drag Chain Middle Link:1
- Angle:10 (0 deg): Drag Chain Support:1 ↔ Drag Chain Middle Link:1
- Flush:20: Drag Chain Start Link:2 ↔ Drag Chain Middle Link:1
- Insert:39: SK8 Linear Shaft Support, 8mm v4:1 ↔ Plain Washer (Metric) 5 N:11
- Insert:40: SK8 Linear Shaft Support, 8mm v4:1 ↔ Plain Washer (Metric) 5 N:12
- Insert:41: SK8 Linear Shaft Support, 8mm v4:2 ↔ Plain Washer (Metric) 5 N:13
- Insert:42: SK8 Linear Shaft Support, 8mm v4:2 ↔ Plain Washer (Metric) 5 N:14
- Insert:43: SHF8:1 ↔ Plain Washer (Metric) 5 N:15
- Insert:44: SHF8:1 ↔ Plain Washer (Metric) 5 N:16
- Insert:45: SHF8_MIR:1 ↔ Plain Washer (Metric) 5 N:18
- Insert:46: SHF8_MIR:1 ↔ Plain Washer (Metric) 5 N:17
- Flush:21 (-2 mm): GT2 Belt 6mm x 40mm:1 ↔ 127x88 Gantry:1
- Flush:22 (7 mm): 2020aluminum_extrusion_black:1 ↔ GT2 Belt 6mm x 40mm:1
- Flush:23 (7 mm): 2020aluminum_extrusion_black:1 ↔ GT2 Belt 6mm x 40mm:2
- Flush:24 (-2 mm): GT2 Belt 6mm x 40mm:2 ↔ 127x88 Gantry:1
- Flush:25: Z Bracket:1 ↔ NO-NC Bump Switch:2
- Insert:47: SK12 SHAFT HOLDER:1 ↔ ISO 4762 M4 x 16:5
## Named parameters: M3_Insert_Nut_Hole = 4 mm, M4_Insert_Nut_Hole = 1 mm, M5_Insert_Nut_Hole = 5.7 mm, d398_d362 = 0 mm, d399_d363 = 0 mm, d400_d364 = 0 mm, d401_d366 = 0 mm, d402_d367 = 0 mm, d403_d368 = 0 mm, d404_d370 = 0 mm, d405_d371 = 0 mm
